# Autodesk Inventor assembly: s1101mfa1000
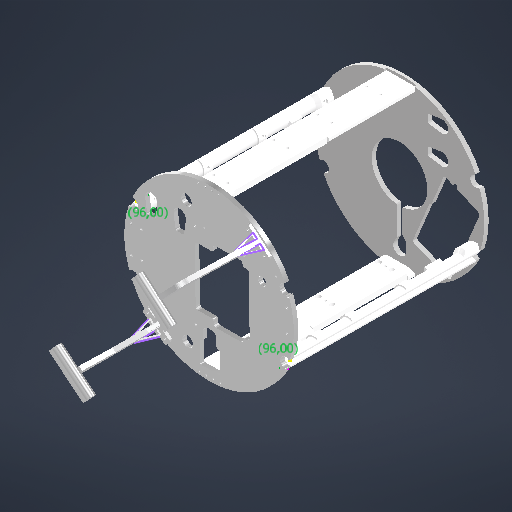
[picture p0: Inventor's stored thumbnail of the model, 512x512]
Saved by Autodesk Inventor 2026.4 (Build 304435000, 435)
## iProperties
Created: 2026-10-25
Part Number: s1101mfa1000
Document SubType Name: Assembly
Designer: User
Sending System: Autodesk Inventor 2027
Preprocessor: ST-DEVELOPER v20.2
Title: s1101mfa1000.stp
Author: User
## Documents named in this file (6)
- D:\NASA\PSI-Documents\Engineering Documents\CADs_Nosso\Expt_Mounting_Structure\Montagens\s1101mfa1000.iam
- D:\NASA\PSI-Documents\Engineering Documents\CADs_Nosso\Expt_Mounting_Structure\Montagens\s1101mfa1000\s1101mfa1003.iam
- D:\NASA\PSI-Documents\Engineering Documents\CADs_Nosso\Expt_Mounting_Structure\Montagens\s1101mfa1000\s1101mfd1014.ipt
- D:\NASA\PSI-Documents\Engineering Documents\CADs_Nosso\Expt_Mounting_Structure\Montagens\s1101mfa1000\s1101mfd1008.ipt
- D:\NASA\PSI-Documents\Engineering Documents\CADs_Nosso\Expt_Mounting_Structure\Montagens\s1101mfa1000\s1101mfa1001.iam
- D:\NASA\PSI-Documents\Engineering Documents\CADs_Nosso\Expt_Mounting_Structure\Montagens\s1101mfa1000\s1101mfd1018.ipt
## Components (8 placed, 5 different names)
1. s1101mfa1003:1 [sub-assembly] — Coincidente:6, Coincidente:7, Coincidente:9
2. s1101mfd1014:1
3. s1101mfd1014:2
4. s1101mfd1008:1 — Coincidente:7, Coincidente:8
5. s1101mfd1008:2 — Coincidente:5, Coincidente:6, Coincidente:9
6. s1101mfa1001:1 [sub-assembly] — Coincidente:1, Coincidente:4, Coincidente:5, Coincidente:8
7. s1101mfd1018:1 — Coincidente:1, Ângulo:1
8. s1101mfd1018:2 — Coincidente:4, Ângulo:2
## Relationships (9: Mate 7, Angle 2)
- Coincidente:1 [Mate]: s1101mfa1001:1 ↔ s1101mfd1018:1
- Coincidente:4 [Mate]: s1101mfa1001:1 ↔ s1101mfd1018:2
- Coincidente:5 [Mate]: s1101mfd1008:2 ↔ s1101mfa1001:1
- Coincidente:6 [Mate]: s1101mfa1003:1 ↔ s1101mfd1008:2
- Coincidente:7 [Mate]: s1101mfa1003:1 ↔ s1101mfd1008:1
- Coincidente:8 [Mate]: s1101mfd1008:1 ↔ s1101mfa1001:1
- Ângulo:1 [Angle] (39.374 deg): s1101mfd1018:1
- Ângulo:2 [Angle] (140.624 deg): s1101mfd1018:2
- Coincidente:9 [Mate]: s1101mfa1003:1 ↔ s1101mfd1008:2
